# Autodesk Inventor assembly: Camera_ball
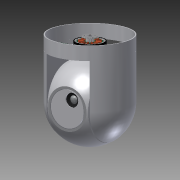
[picture p0: Inventor's stored thumbnail of the model, 180x180]
Saved by Autodesk Inventor 2013 (Build 170138000, 138)
## iProperties
Created: 2013-09-29
Part Number: Camera_ball
Document SubType Name: Assembly
Designer: Hunter
Author: Hunter
## Documents named in this file (20)
- D:\Gimbal\Workspaces\Workspace\Camera_ball.iam
- D:\Gimbal\Workspaces\Workspace\GoPro Hero 3 HD Camera.iam
- D:\Gimbal\Workspaces\Workspace\Gimbal_Motor.iam
- D:\Gimbal\Workspaces\Workspace\GoPro_Mount_Back.ipt
- D:\Gimbal\Workspaces\Workspace\Camera_ball\Design Accelerator\Bolted Connection1.iam
- D:\Gimbal\Workspaces\Workspace\Pitch_Back.ipt
- D:\Gimbal\Workspaces\Workspace\Pitch_Side.ipt
- D:\Gimbal\Workspaces\Workspace\Camera_ball\Design Accelerator\Bolted Connection3.iam
- D:\Gimbal\Workspaces\Workspace\Yaw_Side.ipt
- D:\Gimbal\Workspaces\Workspace\Camera_ball\Design Accelerator\Bolted Connection4.iam
- D:\Gimbal\Workspaces\Workspace\Yaw_Back.ipt
- D:\Gimbal\Workspaces\Workspace\Camera_ball\Design Accelerator\Bolted Connection5.iam
- D:\Gimbal\Workspaces\Workspace\Camera_ball\Design Accelerator\Bolted Connection6.iam
- D:\Gimbal\Workspaces\Workspace\Yaw_Side2.ipt
- D:\Gimbal\Workspaces\Workspace\Imported Components\SMF83_ZZ\SMF83_ZZ.ipt
- D:\Gimbal\Workspaces\Workspace\Ground_Plane.ipt
- D:\Gimbal\Workspaces\Workspace\Ball_Shell.ipt
- D:\Gimbal\Workspaces\Workspace\Ball_arm.ipt
- D:\Gimbal\Workspaces\Workspace\Ball_Base.ipt
- D:\Gimbal\Workspaces\Workspace\Lens_Cover.ipt
## Components (22 placed, 15 different names)
1. GoPro Hero 3 HD Camera:1 [sub-assembly] — Flush:2, Flush:3, Flush:4
2. Gimbal_Motor:1 [sub-assembly] — Mate:13, Mate:14, Mate:15, Flush:11, Mate:19, Mate:20, Mate:39
3. Gimbal_Motor:2 [sub-assembly] — Mate:4, Mate:5, Mate:6, Mate:10, Mate:11, Mate:52
4. Gimbal_Motor:3 [sub-assembly] — Mate:25, Mate:27, Mate:34, Angle:5, Angle:6, Flush:18, Mate:40, Mate:42, Mate:48, Mate:53, Mate:54
5. GoPro_Mount_Back:1 — Flush:2, Mate:4, Mate:5, Mate:6, Mate:7, Mate:8, Flush:3, Flush:4, Angle:3, Mate:31, Flush:26, Angle:11
6. Bolted Connection:1 [sub-assembly] — Mate:7, Mate:8, Mate:31
7. Pitch_Back:1 — Mate:10, Mate:11, Angle:3, Flush:7, Flush:8, Mate:18, Mate:23, Mate:24, Mate:33, Flush:28, Flush:29, Mate:52
8. Pitch_Side:1 — Mate:13, Mate:14, Mate:15, Mate:16, Mate:17, Mate:18, Angle:4, Mate:37, Flush:28, Flush:29, Angle:9
9. Pitch_Side:2 — Flush:7, Flush:8, Mate:38
10. Bolted Connection:2 [sub-assembly] — Mate:16, Mate:17, Mate:37
11. Yaw_Side:1 — Flush:11, Mate:19, Mate:20, Mate:21, Mate:22, Flush:12, Flush:13, Flush:14, Mate:30, Angle:4, Mate:36, Flush:27
12. Bolted Connection:3 [sub-assembly] — Mate:21, Mate:22, Mate:30
13. Yaw_Back:1 — Flush:12, Flush:13, Flush:14, Mate:25, Mate:27, Mate:28, Mate:29, Mate:32, Mate:34, Angle:5, Flush:17, Angle:7, Flush:25, Mate:49, Flush:27, Angle:10
14. Bolted Connection:4 [sub-assembly] — Mate:23, Mate:24, Mate:33
15. Bolted Connection:5 [sub-assembly] — Mate:28, Mate:29, Mate:32
16. Yaw_Side2:1 — Flush:17, Insert:1, Flush:25, Mate:49
17. SMF83_ZZ:1 — Insert:1, Mate:38
18. Ground_Plane:1 — Angle:6, Flush:18
19. Ball_Shell:1 — Mate:39, Angle:9, Mate:50, Mate:51, Mate:54, Mate:56
20. Ball_arm:1 — Flush:19, Flush:20, Flush:21, Flush:22, Mate:55, Angle:10, Mate:56
21. Ball_Base:1 — Flush:21, Flush:22, Mate:48, Mate:55
22. Lens_Cover:1 — Flush:26, Mate:50, Angle:11
## Relationships (73: Mate 44, Flush 20, Angle 8, Insert 1)
- Flush:2 (45 mm): GoPro Hero 3 HD Camera:1 ↔ GoPro_Mount_Back:1
- Mate:4: Gimbal_Motor:2 ↔ GoPro_Mount_Back:1
- Mate:5: Gimbal_Motor:2 ↔ GoPro_Mount_Back:1
- Mate:6: Gimbal_Motor:2 ↔ GoPro_Mount_Back:1
- Mate:7: GoPro_Mount_Back:1 ↔ Bolted Connection:1
- Mate:8: GoPro_Mount_Back:1 ↔ Bolted Connection:1
- Flush:3: GoPro Hero 3 HD Camera:1 ↔ GoPro_Mount_Back:1
- Flush:4: GoPro Hero 3 HD Camera:1 ↔ GoPro_Mount_Back:1
- Mate:10: Gimbal_Motor:2 ↔ Pitch_Back:1
- Mate:11: Gimbal_Motor:2 ↔ Pitch_Back:1
- Angle:3 (0 deg): GoPro_Mount_Back:1 ↔ Pitch_Back:1
- Flush:7: Pitch_Back:1 ↔ Pitch_Side:2
- Flush:8: Pitch_Back:1 ↔ Pitch_Side:2
- Mate:13: Gimbal_Motor:1 ↔ Pitch_Side:1
- Mate:14: Gimbal_Motor:1 ↔ Pitch_Side:1
- Mate:15: Gimbal_Motor:1 ↔ Pitch_Side:1
- Mate:16: Pitch_Side:1 ↔ Bolted Connection:2
- Mate:17: Pitch_Side:1 ↔ Bolted Connection:2
- Mate:18: Pitch_Back:1 ↔ Pitch_Side:1
- Flush:11: Gimbal_Motor:1 ↔ Yaw_Side:1
- Mate:19: Gimbal_Motor:1 ↔ Yaw_Side:1
- Mate:20: Gimbal_Motor:1 ↔ Yaw_Side:1
- Mate:21: Yaw_Side:1 ↔ Bolted Connection:3
- Mate:22: Yaw_Side:1 ↔ Bolted Connection:3
- Flush:12: Yaw_Side:1 ↔ Yaw_Back:1
- Flush:13: Yaw_Side:1 ↔ Yaw_Back:1
- Flush:14: Yaw_Side:1 ↔ Yaw_Back:1
- Mate:23: Pitch_Back:1 ↔ Bolted Connection:4
- Mate:24: Pitch_Back:1 ↔ Bolted Connection:4
- Mate:25: Gimbal_Motor:3 ↔ Yaw_Back:1
- Mate:27: Gimbal_Motor:3 ↔ Yaw_Back:1
- Mate:28: Yaw_Back:1 ↔ Bolted Connection:5
- Mate:29: Yaw_Back:1 ↔ Bolted Connection:5
- Mate:30: Yaw_Side:1 ↔ Bolted Connection:3
- Mate:31: GoPro_Mount_Back:1 ↔ Bolted Connection:1
- Mate:32: Yaw_Back:1 ↔ Bolted Connection:5
- Mate:33: Pitch_Back:1 ↔ Bolted Connection:4
- Mate:34: Gimbal_Motor:3 ↔ Yaw_Back:1
- Angle:4 (0 deg): Pitch_Side:1 ↔ Yaw_Side:1
- Mate:36: Yaw_Side:1
- Angle:5 (10 deg): Gimbal_Motor:3 ↔ Yaw_Back:1
- Mate:37: Pitch_Side:1 ↔ Bolted Connection:2
- Flush:17: Yaw_Back:1 ↔ Yaw_Side2:1
- Insert:1: Yaw_Side2:1 ↔ SMF83_ZZ:1
- Mate:38 (1 mm): Pitch_Side:2 ↔ SMF83_ZZ:1
- Angle:6 (0 deg): Gimbal_Motor:3 ↔ Ground_Plane:1
- Flush:18: Gimbal_Motor:3 ↔ Ground_Plane:1
- Mate:39: Gimbal_Motor:1 ↔ Ball_Shell:1
- Mate:40: Gimbal_Motor:3
- Mate:42: Gimbal_Motor:3
- Mate:45
- Angle:7 (0 deg): Yaw_Back:1
- Flush:19: Ball_arm:1
- Flush:20: Ball_arm:1
- Flush:21: Ball_arm:1 ↔ Ball_Base:1
- Flush:22: Ball_arm:1 ↔ Ball_Base:1
- Mate:48: Gimbal_Motor:3 ↔ Ball_Base:1
- Flush:25: Yaw_Back:1 ↔ Yaw_Side2:1
- Mate:49: Yaw_Back:1 ↔ Yaw_Side2:1
- Flush:26 (75.811 mm): GoPro_Mount_Back:1 ↔ Lens_Cover:1
- Flush:27: Yaw_Side:1 ↔ Yaw_Back:1
- Flush:28: Pitch_Back:1 ↔ Pitch_Side:1
- Flush:29: Pitch_Back:1 ↔ Pitch_Side:1
- Angle:9 (180 deg): Pitch_Side:1 ↔ Ball_Shell:1
- Mate:50: Ball_Shell:1 ↔ Lens_Cover:1
- Mate:51: Ball_Shell:1
- Mate:52: Gimbal_Motor:2 ↔ Pitch_Back:1
- Mate:53: Gimbal_Motor:3
- Mate:54: Gimbal_Motor:3 ↔ Ball_Shell:1
- Mate:55: Ball_arm:1 ↔ Ball_Base:1
- Angle:10 (0 deg): Yaw_Back:1 ↔ Ball_arm:1
- Mate:56: Ball_Shell:1 ↔ Ball_arm:1
- Angle:11 (64.74 deg): GoPro_Mount_Back:1 ↔ Lens_Cover:1
